# Autodesk Inventor assembly: Modullo_led
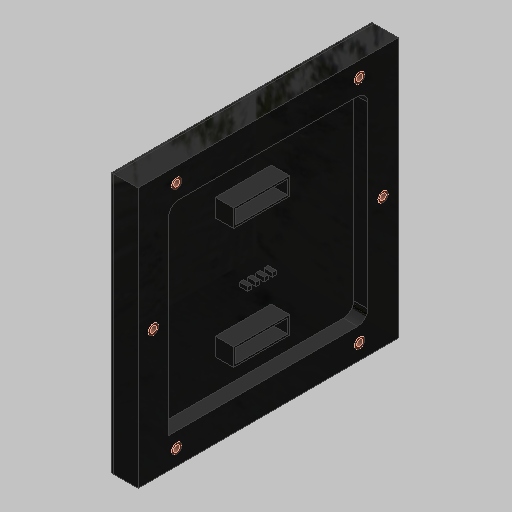
[picture p0: Inventor's stored thumbnail of the model, 512x512]
Saved by Autodesk Inventor 2027 (Build 310192000, 192)
## iProperties
Created: 2026-11-23
Part Number: Modullo_led
Document SubType Name: Assembly
Designer: Alexander
Author: Alexander
## Documents named in this file (4)
- C:\Users\Alexander\Documents\Propuesta_Modelo_3D\Propuesta_Modelo_3D\Modelo V2\Modullo_led.iam
- C:\Users\Alexander\Documents\Propuesta_Modelo_3D\Propuesta_Modelo_3D\Modelo V2\Pantalla_Led_A.ipt
- C:\Users\Alexander\Documents\Propuesta_Modelo_3D\Propuesta_Modelo_3D\Modelo V2\Pantalla_Led_B.ipt
- C:\Users\Alexander\Documents\Propuesta_Modelo_3D\Propuesta_Modelo_3D\Modelo V2\Pantalla_Perno.ipt
## Components (8 placed, 3 different names)
1. Pantalla_Led_A:1 — Coincidencia:1, Nivelación:1, Nivelación:2
2. Pantalla_Led_B:1 — Coincidencia:1, Nivelación:1, Nivelación:2, Insertar:1, Insertar:2, Insertar:3, Insertar:4, Insertar:5, Insertar:6
3. Pantalla_Perno:2 — Insertar:2
4. Pantalla_Perno:3 — Insertar:6
5. Pantalla_Perno:4 — Insertar:5
6. Pantalla_Perno:5 — Insertar:4
7. Pantalla_Perno:6 — Insertar:3
8. Pantalla_Perno:7 — Insertar:1
## Relationships (9: Insert 6, Flush 2, Mate 1)
- Coincidencia:1 [Mate]: Pantalla_Led_A:1 ↔ Pantalla_Led_B:1
- Nivelación:1 [Flush]: Pantalla_Led_A:1 ↔ Pantalla_Led_B:1
- Nivelación:2 [Flush]: Pantalla_Led_A:1 ↔ Pantalla_Led_B:1
- Insertar:1: Pantalla_Led_B:1 ↔ Pantalla_Perno:7
- Insertar:2: Pantalla_Led_B:1 ↔ Pantalla_Perno:2
- Insertar:3: Pantalla_Led_B:1 ↔ Pantalla_Perno:6
- Insertar:4: Pantalla_Led_B:1 ↔ Pantalla_Perno:5
- Insertar:5: Pantalla_Led_B:1 ↔ Pantalla_Perno:4
- Insertar:6: Pantalla_Led_B:1 ↔ Pantalla_Perno:3
